# Autodesk Inventor assembly: 扭力装配体
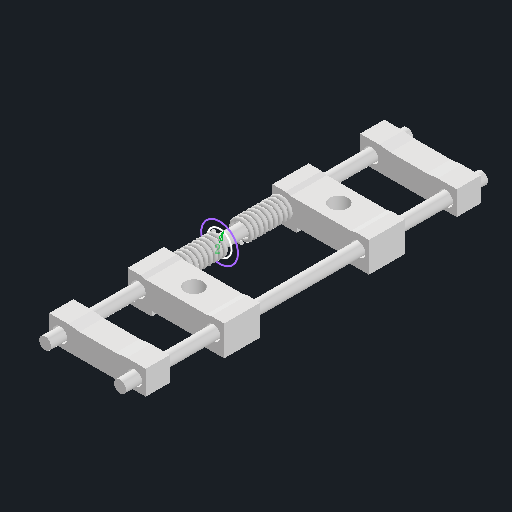
[picture p0: Inventor's stored thumbnail of the model, 512x512]
Saved by Autodesk Inventor 2025 (Build 290162000, 162)
## iProperties
Created: 2025-08-27
Part Number: 扭力装配体
Document SubType Name: Assembly
Designer: HZD
Author: HZD
## Documents named in this file (5)
- D:\2 B Mechanical design\有光\铰链\扭力装配体.iam
- D:\2 B Mechanical design\有光\铰链\扭力模块结构.ipt
- D:\2 B Mechanical design\有光\铰链\轴0.5.ipt
- D:\2 B Mechanical design\有光\铰链\扭簧.ipt
- D:\2 B Mechanical design\有光\铰链\扭力模块结构挡板.ipt
## Components (8 placed, 4 different names)
1. 轴0.5:1 — 配合:2, 表面齐平:5, 配合:6, 配合:18, 配合:20
2. 扭力模块结构:2 — 配合:2, 配合:7
3. 轴0.5:2 — 表面齐平:5, 配合:3, 配合:7, 配合:8, 配合:17, 配合:19, 配合:21
4. 扭力模块结构:3 — 配合:3, 配合:6
5. 扭簧:4 — 配合:8
6. 扭力模块结构挡板:1 — 配合:17, 配合:18
7. 扭力模块结构挡板:2 — 配合:19, 配合:20
8. 扭簧:5 — 配合:21
## Relationships (11: Mate 10, Flush 1)
- 配合:2 [Mate]: 轴0.5:1 ↔ 扭力模块结构:2
- 表面齐平:5 [Flush]: 轴0.5:1 ↔ 轴0.5:2
- 配合:3 [Mate]: 轴0.5:2 ↔ 扭力模块结构:3
- 配合:6 [Mate]: 轴0.5:1 ↔ 扭力模块结构:3
- 配合:7 [Mate]: 扭力模块结构:2 ↔ 轴0.5:2
- 配合:8 [Mate]: 轴0.5:2 ↔ 扭簧:4
- 配合:17 [Mate]: 轴0.5:2 ↔ 扭力模块结构挡板:1
- 配合:18 [Mate]: 轴0.5:1 ↔ 扭力模块结构挡板:1
- 配合:19 [Mate]: 轴0.5:2 ↔ 扭力模块结构挡板:2
- 配合:20 [Mate]: 轴0.5:1 ↔ 扭力模块结构挡板:2
- 配合:21 [Mate]: 轴0.5:2 ↔ 扭簧:5
